# Autodesk Inventor assembly: MM0937AN200_G03_821
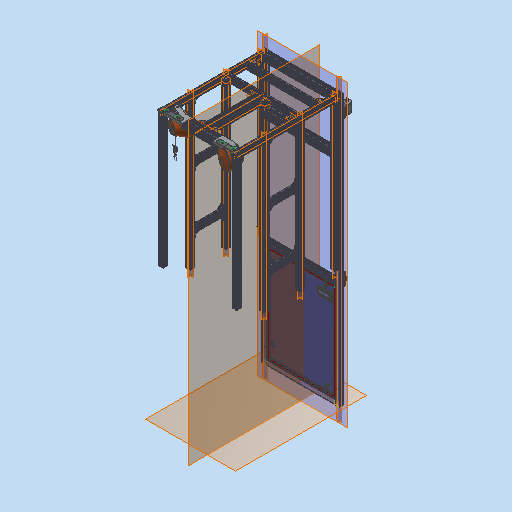
[picture p0: Inventor's stored thumbnail of the model, 512x512]
Saved by Autodesk Inventor 2023.3 (Build 273359000, 359)
## iProperties
Part Number: MM0937AN200_G03_821
Material: Generisch
Description: =<RBPARTNOTITLE2>
Document SubType Name: Assembly
Designer: Benutzer
Mass: 54713.8 g
Surface Area: 171349 cm^2
Volume: 21946.8 cm^3
Density: 2.49302 g/cm^3
RBPARTNOTITLE1: housing  single
AnP_Kategorie: 99
AnP_Material: =<Material>
RBDRAWINGMISSINGSPEC: --
RBPARTMADEOF: --
RBPARTNOTITLE2: Schutz einfach
RBMATERIAL: =<Material>
RBMATNO: =<Part Number>
Author: Benutzer
Keywords: =<RBPARTMADEOF>
Comments: =<RBSURFACE2>
Revision Number: 01
## Documents named in this file (25)
- C:\Users\rea9an\Documents\Inventor\TCAI2412_te1910_EM\AS00000921.iam
- C:\Users\rea9an\Documents\Inventor\TCAI2412_te1910_EM\PT00004330.ipt
- C:\Users\rea9an\Documents\Inventor\TCAI2412_te1910_EM\PT00004331.ipt
- C:\Users\rea9an\Documents\Inventor\TCAI2412_te1910_EM\PT00004301.ipt
- C:\Users\rea9an\Documents\Inventor\TCAI2412_te1910_EM\PT00004338.ipt
- C:\Users\rea9an\Documents\Inventor\TCAI2412_te1910_EM\PT00004312.ipt
- C:\Users\rea9an\Documents\Inventor\TCAI2412_te1910_EM\PT00004332.ipt
- C:\Users\rea9an\Documents\Inventor\TCAI2412_te1910_EM\PT00004350.ipt
- C:\Users\rea9an\Documents\Inventor\TCAI2412_te1910_EM\AS00000898.iam
- C:\Users\rea9an\Documents\Inventor\TCAI2412_te1910_EM\PT00004474.ipt
- C:\Users\rea9an\Documents\Inventor\TCAI2412_te1910_EM\PT00004313.ipt
- C:\Users\rea9an\Documents\Inventor\TCAI2412_te1910_EM\PT00004306.ipt
- C:\Users\rea9an\Documents\Inventor\TCAI2412_te1910_EM\PT00004320.ipt
- C:\Users\rea9an\Documents\Inventor\TCAI2412_te1910_EM\PT00004481.ipt
- C:\Users\rea9an\Documents\Inventor\TCAI2412_te1910_EM\PT00004359.ipt
- C:\Users\rea9an\Documents\Inventor\TCAI2412_te1910_EM\PT00004469.ipt
- C:\Users\rea9an\Documents\Inventor\TCAI2412_te1910_EM\PT00004333.ipt
- C:\Users\rea9an\Documents\Inventor\TCAI2412_te1910_EM\PT00004334.ipt
- C:\Users\rea9an\Documents\Inventor\TCAI2412_te1910_EM\PT00004814.ipt
- C:\Users\rea9an\Documents\Inventor\TCAI2412_te1910_EM\PT00004324.ipt
- C:\Users\rea9an\Documents\Inventor\TCAI2412_te1910_EM\PT00004299.ipt
- C:\Users\rea9an\Documents\Inventor\TCAI2412_te1910_EM\AS00000984.iam
- C:\Users\rea9an\Documents\Inventor\TCAI2412_te1910_EM\PT00004480.ipt
- C:\Users\rea9an\Documents\Inventor\TCAI2412_te1910_EM\PT00004311.ipt
- C:\Users\rea9an\Documents\Inventor\TCAI2412_te1910_EM\AS00000985.iam
## Components (92 placed, 24 different names)
1. PT00004333:2
2. PT00004333:3
3. PT00004334:6
4. PT00004334:7
5. PT00004330:1 — Passend:9, Passend:10, Passend:288, Fluchtend:301, Fluchtend:348, Passend:339
6. PT00004330:2 — Passend:3, Passend:7, Passend:8, Passend:289, Passend:341, Passend:342, Fluchtend:349, Passend:371, Fluchtend:385, Fluchtend:387, Fluchtend:414
7. PT00004331:1 — Passend:3, Fluchtend:123, Fluchtend:177, Fluchtend:383, Passend:383
8. PT00004301:1 — Passend:288, Fluchtend:301, Einfügen:426, Einfügen:427
9. PT00004301:2 — Passend:289, Einfügen:431, Einfügen:433, Passend:373, Fluchtend:411, Fluchtend:415, Passend:385, Fluchtend:416
10. PT00004301:3 — Passend:7, Passend:8, Einfügen:434, Einfügen:435, Einfügen:436, Fluchtend:382, Fluchtend:410
11. PT00004301:4 — Passend:9, Passend:10, Einfügen:428, Einfügen:429, Einfügen:430
12. PT00004334:3
13. PT00004334:5 — Fluchtend:384, Fluchtend:386, Passend:375
14. PT00004334:2
15. PT00004334:4 — Passend:372
16. PT00004331:3 — Fluchtend:123, Passend:69
17. PT00004814:2 — Fluchtend:152, Fluchtend:178, Fluchtend:179, Passend:75, Fluchtend:187, Passend:112, Passend:114, Fluchtend:268, Passend:351, Passend:354, Einfügen:438
18. PT00004814:1 — Passend:56, Fluchtend:166, Passend:111, Einfügen:437, Fluchtend:373, Fluchtend:369, Fluchtend:374, Fluchtend:376, Fluchtend:377, Fluchtend:413
19. PT00004338:1 — Fluchtend:152, Passend:56, Fluchtend:157, Fluchtend:158, Fluchtend:159, Fluchtend:166, Passend:269
20. PT00004312:1 — Fluchtend:160, Passend:57, Passend:58
21. PT00004312:2 — Fluchtend:157, Fluchtend:158, Fluchtend:159, Fluchtend:160, Passend:57, Passend:58
22. PT00004312:3
23. PT00004312:4 — Passend:112, Passend:114, Passend:138
24. PT00004338:4 — Passend:69, Passend:75, Fluchtend:187
25. PT00004312:5 — Passend:111
26. PT00004312:6
27. PT00004338:5 — Fluchtend:177, Fluchtend:178, Fluchtend:179
28. PT00004312:7
29. PT00004312:8
30. PT00004350:1 — Passend:138
31. PT00004332:2
32. PT00004332:4
33. PT00004332:3 — Passend:341
34. PT00004332:1
35. AS00000898:1 [sub-assembly] — Passend:269, Fluchtend:268, Passend:354
36. PT00004474:1
37. PT00004313:1 — Passend:306, Fluchtend:315, Passend:307, Fluchtend:317, Fluchtend:329, Fluchtend:348
38. PT00004313:2 — Passend:306, Fluchtend:315, Fluchtend:318, Passend:309, Passend:318, Fluchtend:325, Fluchtend:326, Fluchtend:329
39. PT00004313:4 — Passend:307, Fluchtend:317, Passend:308, Passend:339
40. PT00004313:5 — Passend:308, Fluchtend:318, Passend:309, Passend:321
41. PT00004313:6 — Passend:318, Fluchtend:325, Fluchtend:326, Fluchtend:330
42. PT00004313:7 — Passend:319, Fluchtend:327, Fluchtend:328, Fluchtend:330
43. PT00004313:8 — Passend:321
44. PT00004313:9 — Passend:320
45. PT00004313:10 — Passend:319, Fluchtend:327, Fluchtend:328
46. PT00004313:12 — Passend:320
47. PT00004313:15
48. PT00004313:17
49. PT00004313:18
50. PT00004313:19
51. PT00004313:20
52. PT00004313:21
53. PT00004313:22
54. PT00004313:23
55. PT00004313:24
56. PT00004313:25 — Passend:342, Fluchtend:349
57. PT00004320:1 — Einfügen:437
58. PT00004320:2 — Einfügen:438
59. PT00004481:1 — Fluchtend:373, Fluchtend:369, Fluchtend:374
60. PT00004359:2 — Einfügen:452
61. PT00004469:1 — Einfügen:452, Fluchtend:376, Fluchtend:377, Fluchtend:413
62. PT00004331:4 — Fluchtend:379, Fluchtend:380, Fluchtend:381, Fluchtend:382, Fluchtend:383, Fluchtend:384, Fluchtend:394
63. PT00004331:5 — Fluchtend:379, Fluchtend:380, Fluchtend:381, Fluchtend:409, Passend:384
64. PT00004324:1 — Fluchtend:385, Passend:372, Passend:373, Fluchtend:399, Passend:377, Fluchtend:407, Passend:381, Passend:382
65. PT00004299:1 — Fluchtend:386, Fluchtend:387, Passend:374, Passend:376, Fluchtend:393, Fluchtend:395
66. PT00004299:2 — Fluchtend:388, Fluchtend:399, Passend:377, Fluchtend:408
67. PT00004299:3 — Fluchtend:390, Passend:375, Passend:376, Fluchtend:393, Fluchtend:401, Fluchtend:406
68. PT00004299:4 — Fluchtend:388, Fluchtend:389, Fluchtend:391, Passend:384, Fluchtend:410
69. PT00004299:6 — Fluchtend:389, Fluchtend:390, Fluchtend:391, Fluchtend:394, Fluchtend:395, Passend:380
70. PT00004299:8 — Fluchtend:401, Fluchtend:409, Passend:383
71. PT00004299:9 — Fluchtend:406, Fluchtend:407, Passend:380
72. PT00004299:10 — Passend:381, Passend:382, Fluchtend:408
73. AS00000984:1 [sub-assembly] — Fluchtend:411, Einfügen:455, Einfügen:456, Einfügen:459, Einfügen:460, Passend:386, Fluchtend:417
74. PT00004480:1 — Einfügen:455
75. PT00004311:1
76. PT00004480:2 — Einfügen:456
77. PT00004311:2
78. PT00004480:3 — Einfügen:459
79. PT00004311:3
80. PT00004480:4 — Einfügen:460
81. PT00004311:4
82. AS00000985:1 [sub-assembly] — Fluchtend:414, Fluchtend:415, Passend:385, Fluchtend:416, Passend:386, Fluchtend:417
83. PT00004306:2 — Einfügen:426
84. PT00004306:3 — Einfügen:427
85. PT00004306:4 — Einfügen:430
86. PT00004306:5 — Einfügen:429
87. PT00004306:6 — Einfügen:428
88. PT00004306:7 — Einfügen:436
89. PT00004306:8 — Einfügen:435
90. PT00004306:9 — Einfügen:434
91. PT00004306:10 — Einfügen:433
92. PT00004306:11 — Einfügen:431
## Relationships (234: Flush 132, Mate 81, Insert 21)
- [Flush]: PT00004333:2 ↔ PT00004333:3
- [Flush]: PT00004333:2 ↔ PT00004334:7
- [Flush]: PT00004334:6 ↔ PT00004334:7
- [Flush]: PT00004333:3 ↔ PT00004334:7
- [Flush] (685 mm): PT00004333:2 ↔ PT00004333:3
- [Flush]: PT00004333:2 ↔ PT00004334:6
- [Flush]: PT00004333:2 ↔ PT00004333:3
- [Flush]: PT00004333:3 ↔ PT00004334:7
- [Flush]: PT00004333:2 ↔ PT00004334:6
- [Flush] (915 mm): PT00004333:3 ↔ PT00004334:7
- [Flush]: PT00004334:6 ↔ PT00004334:7
- [Flush]: PT00004330:1 ↔ PT00004330:2
- [Flush]: PT00004330:1 ↔ PT00004330:2
- [Mate] (-22.5 mm): PT00004334:7 ↔ PT00004330:1
- [Flush]: PT00004333:3 ↔ PT00004330:2
- [Mate] (-22.5 mm): PT00004334:7 ↔ PT00004330:2
- Passend:3 [Mate]: PT00004330:2 ↔ PT00004331:1
- [Flush]: PT00004334:6 ↔ PT00004331:1
- [Flush]: PT00004333:3 ↔ PT00004301:2
- [Mate] (22.5 mm): PT00004333:3 ↔ PT00004301:2
- Passend:7 [Mate]: PT00004330:2 ↔ PT00004301:3
- Passend:8 [Mate]: PT00004330:2 ↔ PT00004301:3
- [Flush]: PT00004334:7 ↔ PT00004301:3
- Passend:9 [Mate]: PT00004330:1 ↔ PT00004301:4
- Passend:10 [Mate]: PT00004330:1 ↔ PT00004301:4
- [Mate]: PT00004334:6 ↔ PT00004301:4
- [Flush]: PT00004334:6 ↔ PT00004334:3
- [Flush]: PT00004334:6 ↔ PT00004334:3
- [Flush] (330 mm): PT00004334:6 ↔ PT00004334:3
- [Flush]: PT00004334:3 ↔ PT00004334:5
- [Flush]: PT00004334:3 ↔ PT00004334:5
- [Flush]: PT00004334:7 ↔ PT00004334:5
- [Flush]: PT00004334:3 ↔ PT00004334:2
- [Flush]: PT00004334:3 ↔ PT00004334:2
- [Flush] (253 mm): PT00004333:2 ↔ PT00004334:2
- [Flush]: PT00004334:2 ↔ PT00004334:4
- [Flush]: PT00004333:3 ↔ PT00004334:4
- [Flush]: PT00004334:2 ↔ PT00004334:4
- [Flush]: PT00004334:7 ↔ PT00004331:3
- [Mate] (-22.5 mm): PT00004334:6 ↔ PT00004331:3
- Fluchtend:123 [Flush] (455 mm): PT00004331:1 ↔ PT00004331:3
- [Flush]: PT00004814:2 ↔ PT00004814:1
- [Flush]: PT00004814:2 ↔ PT00004814:1
- [Flush]: PT00004334:6 ↔ PT00004814:1
- [Flush] (-35 mm): PT00004334:7 ↔ PT00004814:2
- [Mate] (2470 mm): PT00004334:7 ↔ PT00004814:2
- [Flush]: PT00004334:7 ↔ PT00004814:2
- Fluchtend:152 [Flush]: PT00004814:2 ↔ PT00004338:1
- Passend:56 [Mate] (-22.5 mm): PT00004814:1 ↔ PT00004338:1
- Fluchtend:157 [Flush]: PT00004338:1 ↔ PT00004312:2
- Fluchtend:158 [Flush] (-22.5 mm): PT00004338:1 ↔ PT00004312:2
- Fluchtend:159 [Flush] (-2.5 mm): PT00004338:1 ↔ PT00004312:2
- Fluchtend:160 [Flush]: PT00004312:1 ↔ PT00004312:2
- Passend:57 [Mate] (640 mm): PT00004312:1 ↔ PT00004312:2
- Passend:58 [Mate]: PT00004312:1 ↔ PT00004312:2
- [Flush]: PT00004312:3 ↔ PT00004312:4
- [Mate] (640 mm): PT00004312:3 ↔ PT00004312:4
- [Mate]: PT00004312:3 ↔ PT00004312:4
- Fluchtend:166 [Flush] (-18.5 mm): PT00004814:1 ↔ PT00004338:1
- [Flush]: PT00004338:4 ↔ PT00004312:6
- [Flush] (-22.5 mm): PT00004338:4 ↔ PT00004312:6
- [Flush]: PT00004312:5 ↔ PT00004312:6
- [Mate] (640 mm): PT00004312:5 ↔ PT00004312:6
- [Mate]: PT00004312:5 ↔ PT00004312:6
- [Flush]: PT00004338:5 ↔ PT00004312:8
- [Flush] (-22.5 mm): PT00004338:5 ↔ PT00004312:8
- [Flush] (-2.5 mm): PT00004338:5 ↔ PT00004312:8
- [Flush]: PT00004312:7 ↔ PT00004312:8
- [Mate] (640 mm): PT00004312:7 ↔ PT00004312:8
- [Mate]: PT00004312:7 ↔ PT00004312:8
- Fluchtend:177 [Flush]: PT00004331:1 ↔ PT00004338:5
- Fluchtend:178 [Flush]: PT00004814:2 ↔ PT00004338:5
- Fluchtend:179 [Flush] (-22.5 mm): PT00004814:2 ↔ PT00004338:5
- Passend:69 [Mate]: PT00004331:3 ↔ PT00004338:4
- [Mate] (640 mm): PT00004338:1 ↔ PT00004350:1
- [Mate] (2.5 mm): PT00004814:2 ↔ PT00004350:1
- [Flush] (-966.5 mm): PT00004338:1 ↔ PT00004350:1
- Passend:75 [Mate] (5 mm): PT00004814:2 ↔ PT00004338:4
- Fluchtend:187 [Flush] (-22.5 mm): PT00004814:2 ↔ PT00004338:4
- [Flush]: PT00004332:2 ↔ PT00004332:4
- [Flush]: PT00004332:2 ↔ PT00004332:4
- [Mate] (-22.5 mm): PT00004334:3 ↔ PT00004332:2
- [Flush]: PT00004334:3 ↔ PT00004332:2
- [Flush]: PT00004334:5 ↔ PT00004332:4
- [Flush]: PT00004334:3 ↔ PT00004332:1
- [Flush]: PT00004332:2 ↔ PT00004332:1
- [Flush] (540 mm): PT00004332:2 ↔ PT00004332:1
- [Flush]: PT00004332:3 ↔ PT00004332:1
- [Flush]: PT00004332:4 ↔ PT00004332:3
- [Flush]: PT00004332:3 ↔ PT00004332:1
- Passend:111 [Mate]: PT00004814:1 ↔ PT00004312:5
- Passend:112 [Mate]: PT00004814:2 ↔ PT00004312:4
- Passend:114 [Mate]: PT00004814:2 ↔ PT00004312:4
- Passend:138 [Mate] (-30 mm): PT00004312:4 ↔ PT00004350:1
- Passend:269 [Mate] (22.5 mm): PT00004338:1 ↔ AS00000898:1
- Fluchtend:268 [Flush] (-22.5 mm): PT00004814:2 ↔ AS00000898:1
- [Mate] (-28 mm): PT00004333:2 ↔ PT00004474:1
- [Mate] (-22.5 mm): PT00004334:6 ↔ PT00004331:1
- Passend:288 [Mate]: PT00004330:1 ↔ PT00004301:1
- [Flush]: PT00004333:2 ↔ PT00004301:1
- Fluchtend:301 [Flush] (22.5 mm): PT00004330:1 ↔ PT00004301:1
- Passend:289 [Mate]: PT00004330:2 ↔ PT00004301:2
- Passend:306 [Mate]: PT00004313:1 ↔ PT00004313:2
- Fluchtend:315 [Flush]: PT00004313:1 ↔ PT00004313:2
- Passend:307 [Mate]: PT00004313:1 ↔ PT00004313:4
- Fluchtend:317 [Flush]: PT00004313:1 ↔ PT00004313:4
- Passend:308 [Mate]: PT00004313:4 ↔ PT00004313:5
- Fluchtend:318 [Flush]: PT00004313:2 ↔ PT00004313:5
- Passend:309 [Mate]: PT00004313:2 ↔ PT00004313:5
- [Mate]: PT00004313:6 ↔ PT00004313:7
- [Flush]: PT00004313:6 ↔ PT00004313:7
- [Mate]: PT00004313:6 ↔ PT00004313:8
- [Flush]: PT00004313:6 ↔ PT00004313:8
- [Mate]: PT00004313:8 ↔ PT00004313:9
- [Flush]: PT00004313:7 ↔ PT00004313:9
- [Mate]: PT00004313:7 ↔ PT00004313:9
- [Mate]: PT00004313:10 ↔ PT00004313:12
- [Flush]: PT00004313:10 ↔ PT00004313:12
- Passend:318 [Mate]: PT00004313:2 ↔ PT00004313:6
- Fluchtend:325 [Flush] (45 mm): PT00004313:2 ↔ PT00004313:6
- Fluchtend:326 [Flush]: PT00004313:2 ↔ PT00004313:6
- Passend:319 [Mate]: PT00004313:7 ↔ PT00004313:10
- Fluchtend:327 [Flush] (45 mm): PT00004313:7 ↔ PT00004313:10
- Fluchtend:328 [Flush]: PT00004313:7 ↔ PT00004313:10
- Passend:320 [Mate]: PT00004313:9 ↔ PT00004313:12
- Passend:321 [Mate]: PT00004313:5 ↔ PT00004313:8
- Fluchtend:329 [Flush] (-495 mm): PT00004313:1 ↔ PT00004313:2
- Fluchtend:330 [Flush] (-495 mm): PT00004313:6 ↔ PT00004313:7
- [Flush]: PT00004313:15 ↔ PT00004313:17
- [Mate]: PT00004313:15 ↔ PT00004313:17
- [Mate]: PT00004313:18 ↔ PT00004313:19
- [Flush]: PT00004313:18 ↔ PT00004313:19
- [Mate]: PT00004313:18 ↔ PT00004313:20
- [Flush]: PT00004313:18 ↔ PT00004313:20
- [Mate]: PT00004313:20 ↔ PT00004313:21
- [Flush]: PT00004313:19 ↔ PT00004313:21
- [Mate]: PT00004313:19 ↔ PT00004313:21
- [Mate]: PT00004313:22 ↔ PT00004313:23
- [Flush]: PT00004313:22 ↔ PT00004313:23
- [Mate]: PT00004313:22 ↔ PT00004313:24
- [Flush]: PT00004313:22 ↔ PT00004313:24
- [Mate]: PT00004313:24 ↔ PT00004313:25
- [Flush]: PT00004313:23 ↔ PT00004313:25
- [Mate]: PT00004313:23 ↔ PT00004313:25
- [Mate]: PT00004313:15 ↔ PT00004313:18
- [Flush] (45 mm): PT00004313:15 ↔ PT00004313:18
- [Flush]: PT00004313:15 ↔ PT00004313:18
- [Mate]: PT00004313:19 ↔ PT00004313:22
- [Flush] (45 mm): PT00004313:19 ↔ PT00004313:22
- [Flush]: PT00004313:19 ↔ PT00004313:22
- [Mate]: PT00004313:21 ↔ PT00004313:24
- [Mate]: PT00004313:17 ↔ PT00004313:20
- [Flush] (-495 mm): PT00004313:18 ↔ PT00004313:19
- [Flush] (-495 mm): PT00004313:22 ↔ PT00004313:23
- Fluchtend:348 [Flush]: PT00004330:1 ↔ PT00004313:1
- [Mate] (22.5 mm): PT00004334:2 ↔ PT00004313:4
- Passend:339 [Mate] (-22.5 mm): PT00004330:1 ↔ PT00004313:4
- [Mate] (-22.5 mm): PT00004334:3 ↔ PT00004313:1
- Passend:341 [Mate] (-540 mm): PT00004330:2 ↔ PT00004332:3
- Passend:342 [Mate]: PT00004330:2 ↔ PT00004313:25
- Fluchtend:349 [Flush] (22.5 mm): PT00004330:2 ↔ PT00004313:25
- [Flush] (-22.5 mm): PT00004334:4 ↔ PT00004313:25
- Passend:351 [Mate]: PT00004814:2
- Passend:354 [Mate]: PT00004814:2 ↔ AS00000898:1
- Einfügen:426 [Insert]: PT00004301:1 ↔ PT00004306:2
- Einfügen:427 [Insert]: PT00004301:1 ↔ PT00004306:3
- Einfügen:428 [Insert]: PT00004301:4 ↔ PT00004306:6
- Einfügen:429 [Insert]: PT00004301:4 ↔ PT00004306:5
- Einfügen:430 [Insert]: PT00004301:4 ↔ PT00004306:4
- Einfügen:431 [Insert]: PT00004301:2 ↔ PT00004306:11
- Einfügen:433 [Insert]: PT00004301:2 ↔ PT00004306:10
- Einfügen:434 [Insert]: PT00004301:3 ↔ PT00004306:9
- Einfügen:435 [Insert]: PT00004301:3 ↔ PT00004306:8
- Einfügen:436 [Insert]: PT00004301:3 ↔ PT00004306:7
- Einfügen:437 [Insert] (-12 mm): PT00004814:1 ↔ PT00004320:1
- Einfügen:438 [Insert] (-12 mm): PT00004814:2 ↔ PT00004320:2
- Fluchtend:373 [Flush] (-10 mm): PT00004814:1 ↔ PT00004481:1
- Fluchtend:369 [Flush] (-34 mm): PT00004814:1 ↔ PT00004481:1
- Fluchtend:374 [Flush] (-1030 mm): PT00004814:1 ↔ PT00004481:1
- Einfügen:452 [Insert] (-3 mm): PT00004359:2 ↔ PT00004469:1
- Fluchtend:376 [Flush] (-17 mm): PT00004814:1 ↔ PT00004469:1
- Fluchtend:377 [Flush] (-6 mm): PT00004814:1 ↔ PT00004469:1
- [Flush] (22.5 mm): PT00004333:2 ↔ PT00004301:1
- Passend:371 [Mate] (-365 mm): PT00004330:2
- Fluchtend:379 [Flush]: PT00004331:4 ↔ PT00004331:5
- Fluchtend:380 [Flush]: PT00004331:4 ↔ PT00004331:5
- Fluchtend:381 [Flush] (185 mm): PT00004331:4 ↔ PT00004331:5
- Fluchtend:382 [Flush]: PT00004301:3 ↔ PT00004331:4
- Fluchtend:383 [Flush]: PT00004331:1 ↔ PT00004331:4
- Fluchtend:384 [Flush]: PT00004334:5 ↔ PT00004331:4
- Fluchtend:385 [Flush]: PT00004330:2 ↔ PT00004324:1
- Passend:372 [Mate] (342.5 mm): PT00004334:4 ↔ PT00004324:1
- Passend:373 [Mate] (-45 mm): PT00004301:2 ↔ PT00004324:1
- Fluchtend:386 [Flush] (22.5 mm): PT00004334:5 ↔ PT00004299:1
- Fluchtend:387 [Flush]: PT00004330:2 ↔ PT00004299:1
- Passend:374 [Mate] (-45 mm): PT00004299:1
- Fluchtend:388 [Flush]: PT00004299:2 ↔ PT00004299:4
- Fluchtend:389 [Flush]: PT00004299:4 ↔ PT00004299:6
- Fluchtend:390 [Flush]: PT00004299:3 ↔ PT00004299:6
- Fluchtend:391 [Flush]: PT00004299:4 ↔ PT00004299:6
- Passend:375 [Mate] (22.5 mm): PT00004334:5 ↔ PT00004299:3
- Passend:376 [Mate]: PT00004299:1 ↔ PT00004299:3
- Fluchtend:393 [Flush]: PT00004299:1 ↔ PT00004299:3
- Fluchtend:394 [Flush]: PT00004331:4 ↔ PT00004299:6
- Fluchtend:395 [Flush]: PT00004299:1 ↔ PT00004299:6
- Fluchtend:399 [Flush]: PT00004324:1 ↔ PT00004299:2
- Passend:377 [Mate] (45 mm): PT00004324:1 ↔ PT00004299:2
- Fluchtend:401 [Flush]: PT00004299:3 ↔ PT00004299:8
- Fluchtend:406 [Flush]: PT00004299:3 ↔ PT00004299:9
- Fluchtend:407 [Flush] (45 mm): PT00004324:1 ↔ PT00004299:9
- Passend:380 [Mate]: PT00004299:6 ↔ PT00004299:9
- Passend:381 [Mate] (-45 mm): PT00004324:1 ↔ PT00004299:10
- Passend:382 [Mate]: PT00004324:1 ↔ PT00004299:10
- Fluchtend:408 [Flush]: PT00004299:2 ↔ PT00004299:10
- Fluchtend:409 [Flush] (-22.5 mm): PT00004331:5 ↔ PT00004299:8
- Passend:383 [Mate]: PT00004331:1 ↔ PT00004299:8
- Passend:384 [Mate] (22.5 mm): PT00004331:5 ↔ PT00004299:4
- Fluchtend:410 [Flush] (-22.5 mm): PT00004301:3 ↔ PT00004299:4
- Fluchtend:411 [Flush] (1 mm): PT00004301:2 ↔ AS00000984:1
- Fluchtend:413 [Flush] (100 mm): PT00004814:1 ↔ PT00004469:1
- [Insert] (5 mm): PT00004480:1 ↔ PT00004311:1
- [Insert] (5 mm): PT00004480:2 ↔ PT00004311:2
- Einfügen:455 [Insert]: AS00000984:1 ↔ PT00004480:1
- Einfügen:456 [Insert]: AS00000984:1 ↔ PT00004480:2
- [Insert] (5 mm): PT00004480:3 ↔ PT00004311:3
- [Insert] (5 mm): PT00004480:4 ↔ PT00004311:4
- Einfügen:459 [Insert]: AS00000984:1 ↔ PT00004480:3
- Einfügen:460 [Insert]: AS00000984:1 ↔ PT00004480:4
- Fluchtend:414 [Flush]: PT00004330:2 ↔ AS00000985:1
- Fluchtend:415 [Flush]: PT00004301:2 ↔ AS00000985:1
- Passend:385 [Mate]: PT00004301:2 ↔ AS00000985:1
- Fluchtend:416 [Flush]: PT00004301:2 ↔ AS00000985:1
- Passend:386 [Mate]: AS00000984:1 ↔ AS00000985:1
- Fluchtend:417 [Flush]: AS00000984:1 ↔ AS00000985:1
## Named parameters: d236_d231 = 0 mm, d237_d232 = 640 mm, d238_d233 = 0 mm, d247_d229 = -22.5 mm, d249_d231 = 0 mm, d250_d232 = 640 mm, d251_d233 = 0 mm, d252_d228 = 0 mm, d253_d229 = -22.5 mm, d254_d230 = -2.5 mm, d255_d231 = 0 mm, d256_d232 = 640 mm, d257_d233 = 0 mm, d258_d228 = 0 mm, d532_d530 = 0 mm, d533_d531 = 0 mm, d534_d524 = 0 mm, d535_d525 = 0 mm, d536_d527 = 0 mm, d537_d528 = 0 mm, d538_d529 = 0 mm, d543_d527 = 0 mm, d544_d528 = 0 mm, d558_d555 = -495 mm, d559_d556 = -495 mm, d560_d530 = 0 mm, d561_d531 = 0 mm, d562_d532_d530 = 0 mm, d563_d533_d531 = 0 mm, d564_d534_d524 = 0 mm, d565_d535_d525 = 0 mm, d566_d536_d527 = 0 mm, d567_d537_d528 = 0 mm, d568_d538_d529 = 0 mm, d569_d539_d530 = 0 mm, d570_d540_d531 = 0 mm, d571_d541_d524 = 0 mm, d572_d542_d525 = 0 mm, d573_d543_d527 = 0 mm, d574_d544_d528 = 0 mm, d575_d545_d529 = 0 mm, d576_d546 = 0 mm, d577_d547 = 45 mm, d578_d548 = 0 mm, d579_d549 = 0 mm, d580_d550 = 45 mm, d581_d551 = 0 mm, d582_d552 = 0 mm, d583_d553 = 0 mm, d34_d725_d707 = 5 mm, d1222_d34_d725_d707 = 5 mm, d1225_d34_d725_d707 = 5 mm, d1226_d34_d725_d707 = 5 mm
